# Autodesk Inventor assembly: 2
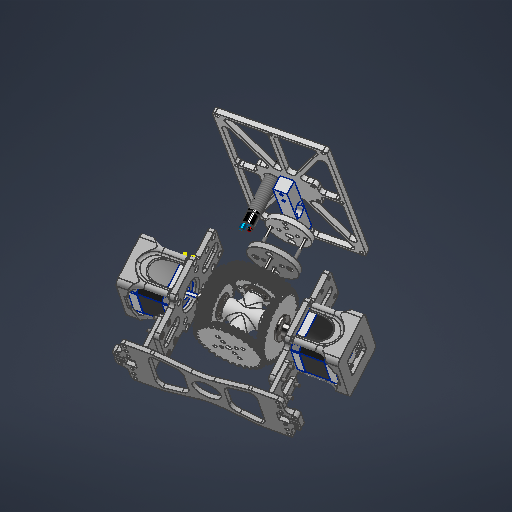
[picture p0: Inventor's stored thumbnail of the model, 512x512]
Saved by Autodesk Inventor 2026.2 (Build 302298010, 298A)
## iProperties
Created: 2026-03-18
Part Number: 2
Document SubType Name: Assembly
Designer: work
Author: work
## Documents named in this file (31)
- C:\Users\work\Desktop\ARD_v1\ARD_hardware\ARD_Model_v1\2.iam
- C:\Users\work\Desktop\ARD_v1\ARD_hardware\ARD_Model_v1\1\A.ipt
- C:\Users\work\Desktop\ARD_v1\ARD_hardware\ARD_Model_v1\C.ipt
- C:\Users\work\Desktop\ARD_v1\ARD_hardware\ARD_Model_v1\Object\JIS B 1521 SKF (D) - SKF 608-Z.ipt
- C:\Users\work\Desktop\ARD_v1\ARD_hardware\ARD_Model_v1\5_Co.ipt
- C:\Users\work\Desktop\ARD_v1\ARD_hardware\ARD_Model_v1\NEMA17.ipt
- C:\Users\work\Desktop\ARD_v1\ARD_hardware\ARD_Model_v1\1\B.ipt
- C:\Users\work\Desktop\ARD_v1\ARD_hardware\ARD_Model_v1\R-2.ipt
- C:\Users\work\Desktop\ARD_v1\ARD_hardware\ARD_Model_v1\Object\로드셀 센서.ipt
- C:\Users\work\Desktop\ARD_v1\ARD_hardware\ARD_Model_v1\as5600_holder.ipt
- C:\Users\work\Desktop\ARD_v1\ARD_hardware\ARD_Model_v1\hol.ipt
- C:\Users\work\Desktop\ARD_v1\ARD_hardware\ARD_Model_v1\RALI1.ipt
- C:\Users\work\Desktop\ARD_v1\ARD_hardware\ARD_Model_v1\magnet_as5600.ipt
- C:\Users\work\Documents\Inventor\Content Center Files\R2026\ko-KR\KS B 1003\KS B 1003 - M 3 x 10.ipt
- C:\Users\work\Desktop\ARD_v1\ARD_hardware\ARD_Model_v1\lj12.ipt
- C:\Users\work\Desktop\ARD_v1\ARD_hardware\ARD_Model_v1\coupler.ipt
- C:\Users\work\Desktop\ARD_v1\ARD_hardware\PL121248Drive_v1\R2-v2.ipt
- C:\Users\work\Desktop\ARD_v1\ARD_hardware\ARD_Model_v1\KS B 1003 - M 3 x 30.ipt
- C:\Users\work\Desktop\ARD_v1\ARD_hardware\ARD_Model_v1\KS B 1003 - M 4 x 10.ipt
- C:\Users\work\Desktop\ARD_v1\ARD_hardware\ARD_Model_v1\2B_set\AIP\FEA\fdflh83ds.fins
- C:\Users\work\Desktop\ARD_v1\ARD_hardware\ARD_Model_v1\2B_set\AIP\FEA\fdflh83ds.fsat
- C:\Users\work\Desktop\ARD_v1\ARD_hardware\ARD_Model_v1\2B_set\AIP\FEA\fdflh83ds.ftes
- C:\Users\work\Desktop\ARD_v1\ARD_hardware\ARD_Model_v1\2B_set\AIP\FEA\fdflh83ds.fwiz
- C:\Users\work\Desktop\ARD_v1\ARD_hardware\ARD_Model_v1\2B_set_rali\AIP\FEA\fdjqx1t5s.fins
- C:\Users\work\Desktop\ARD_v1\ARD_hardware\ARD_Model_v1\2B_set_rali\AIP\FEA\fdjqx1t5s.fsat
- C:\Users\work\Desktop\ARD_v1\ARD_hardware\ARD_Model_v1\2B_set_rali\AIP\FEA\fdjqx1t5s.ftes
- C:\Users\work\Desktop\ARD_v1\ARD_hardware\ARD_Model_v1\2B_set_rali\AIP\FEA\fdjqx1t5s.fwiz
- C:\Users\work\Desktop\ARD_v1\ARD_hardware\ARD_Model_v1\2\AIP\FEA\fdyt8wk5c.fins
- C:\Users\work\Desktop\ARD_v1\ARD_hardware\ARD_Model_v1\2\AIP\FEA\fdyt8wk5c.fsat
- C:\Users\work\Desktop\ARD_v1\ARD_hardware\ARD_Model_v1\2\AIP\FEA\fdyt8wk5c.ftes
- C:\Users\work\Desktop\ARD_v1\ARD_hardware\ARD_Model_v1\2\AIP\FEA\fdyt8wk5c.fwiz
## Components (38 placed, 18 different names)
1. lj12:1 — 회전:48
2. R2-v2:1 — 회전:48, 메이트:70, 메이트:71, 메이트:72, 회전:49, 회전:50, 각도:8
3. coupler:1 — 회전:44, 회전:45, 메이트:68, 메이트:69, 플러쉬:5
4. KS B 1003 - M 3 x 30:1 — 회전:45, 플러쉬:6
5. KS B 1003 - M 3 x 30:2 — 회전:44
6. KS B 1003 - M 3 x 30:3 — 회전:46, 메이트:68, 플러쉬:5
7. KS B 1003 - M 3 x 30:4 — 회전:47, 메이트:69
8. KS B 1003 - M 4 x 10:1 — 회전:49
9. KS B 1003 - M 4 x 10:2 — 회전:50
10. as5600_holder:2 — 메이트:55, 메이트:56, 메이트:57
11. hol:2 — 메이트:53, 메이트:54, 각도:7, 메이트:56, 메이트:57, 메이트:61, 메이트:62, 메이트:63, 강체:3, 회전:37, 회전:38, 회전:39
12. hol:1 — 메이트:51, 각도:5, 메이트:52, 메이트:58, 메이트:59, 회전:40, 회전:41, 회전:42, 회전:43
13. RALI1:1 — 메이트:61, 메이트:62, 메이트:63, 각도:8
14. as5600_holder:1 — 메이트:58, 메이트:59, 메이트:60
15. B:2 — 회전:3
16. R-2:1 — 메이트:35, 메이트:36, 메이트:38, 메이트:39, 메이트:47, 회전:46, 회전:47
17. A:1 — 메이트:1, 메이트:2, 메이트:11, 메이트:19, 메이트:22, 메이트:23, 회전:1, 각도:1
18. C:1 — 메이트:7, 메이트:8, 메이트:9, 메이트:10, 메이트:11, 메이트:27, 각도:4, 메이트:50, 플러쉬:3
19. A:2 — 메이트:10, 메이트:20, 메이트:21, 메이트:24, 회전:2
20. 5_Co:4 — 메이트:22, 메이트:23, 메이트:54
21. 5_Co:3 — 메이트:15, 플러쉬:1, 메이트:21, 메이트:24, 회전:3
22. B:1 — 메이트:25, 메이트:26, 메이트:27, 회전:1, 회전:2, 메이트:35, 메이트:36, 플러쉬:6
23. JIS B 1521 SKF (D) - SKF 608-Z:4 — 메이트:50, 플러쉬:3
24. KS B 1003 - 미터 M 3 x 10:13 — 회전:38
25. KS B 1003 - 미터 M 3 x 10:14 — 회전:37
26. KS B 1003 - 미터 M 3 x 10:15 — 회전:39
27. KS B 1003 - 미터 M 3 x 10:16 — 강체:3
28. KS B 1003 - 미터 M 3 x 10:17 — 회전:41
29. KS B 1003 - 미터 M 3 x 10:18 — 회전:42
30. KS B 1003 - 미터 M 3 x 10:19 — 회전:43
31. KS B 1003 - 미터 M 3 x 10:20 — 회전:40
32. magnet_as5600:2 — 메이트:66, 메이트:67
33. JIS B 1521 SKF (D) - SKF 608-Z:2 — 메이트:8
34. JIS B 1521 SKF (D) - SKF 608-Z:3 — 메이트:7, 메이트:25, 메이트:26
35. JIS B 1521 SKF (D) - SKF 608-Z:1 — 메이트:1, 메이트:2, 메이트:9
36. NEMA17:1 — 메이트:15, 플러쉬:1, 메이트:20, 각도:4, 메이트:51, 각도:5, 각도:6, 메이트:52, 메이트:60, 메이트:66, 메이트:67
37. NEMA17:2 — 메이트:19, 각도:1, 각도:6, 메이트:53, 각도:7, 메이트:55
38. 로드셀 센서:1 — 메이트:38, 메이트:39, 메이트:47, 메이트:70, 메이트:71, 메이트:72
## Relationships (77: Mate 48, RevoluteJoint 14, Angle 6, Flush 5, RelateRotation 3, WeldJoint 1)
- 메이트:1 [Mate]: A:1 ↔ JIS B 1521 SKF (D) - SKF 608-Z:1
- 메이트:2 [Mate]: A:1 ↔ JIS B 1521 SKF (D) - SKF 608-Z:1
- [Mate]: A:2 ↔ JIS B 1521 SKF (D) - SKF 608-Z:2
- [Mate]: A:2 ↔ JIS B 1521 SKF (D) - SKF 608-Z:2
- 메이트:7 [Mate]: C:1 ↔ JIS B 1521 SKF (D) - SKF 608-Z:3
- 메이트:8 [Mate]: C:1 ↔ JIS B 1521 SKF (D) - SKF 608-Z:2
- 메이트:9 [Mate]: C:1 ↔ JIS B 1521 SKF (D) - SKF 608-Z:1
- 메이트:10 [Mate]: C:1 ↔ A:2
- 메이트:11 [Mate]: A:1 ↔ C:1
- 메이트:15 [Mate]: 5_Co:3 ↔ NEMA17:1
- 플러쉬:1 [Flush]: 5_Co:3 ↔ NEMA17:1
- [Mate]: 5_Co:4 ↔ NEMA17:2
- [Flush]: 5_Co:4 ↔ NEMA17:2
- 메이트:19 [Mate]: A:1 ↔ NEMA17:2
- 메이트:20 [Mate]: A:2 ↔ NEMA17:1
- 메이트:21 [Mate]: A:2 ↔ 5_Co:3
- 메이트:22 [Mate]: A:1 ↔ 5_Co:4
- 메이트:23 [Mate]: A:1 ↔ 5_Co:4
- 메이트:24 [Mate]: A:2 ↔ 5_Co:3
- 메이트:25 [Mate]: B:1 ↔ JIS B 1521 SKF (D) - SKF 608-Z:3
- 메이트:26 [Mate]: B:1 ↔ JIS B 1521 SKF (D) - SKF 608-Z:3
- 메이트:27 [Mate]: C:1 ↔ B:1
- 회전:1 [RelateRotation] (1 ul): A:1 ↔ B:1
- 회전:2 [RelateRotation] (1 ul): A:2 ↔ B:1
- 각도:1 [Angle] (720 deg): A:1 ↔ NEMA17:2
- 각도:4 [Angle] (180 deg): C:1 ↔ NEMA17:1
- 메이트:35 [Mate]: R-2:1 ↔ B:1
- 메이트:36 [Mate]: R-2:1 ↔ B:1
- 메이트:38 [Mate]: R-2:1 ↔ 로드셀 센서:1
- 메이트:39 [Mate]: R-2:1 ↔ 로드셀 센서:1
- 메이트:47 [Mate]: R-2:1 ↔ 로드셀 센서:1
- [Mate]: B:2 ↔ JIS B 1521 SKF (D) - SKF 608-Z:4
- [Mate]: B:2 ↔ JIS B 1521 SKF (D) - SKF 608-Z:4
- 메이트:50 [Mate]: C:1 ↔ JIS B 1521 SKF (D) - SKF 608-Z:4
- 플러쉬:3 [Flush]: C:1 ↔ JIS B 1521 SKF (D) - SKF 608-Z:4
- 회전:3 [RelateRotation] (1 ul): B:2 ↔ 5_Co:3
- 메이트:51 [Mate]: hol:1 ↔ NEMA17:1
- 각도:5 [Angle] (0 deg): hol:1 ↔ NEMA17:1
- 각도:6 [Angle] (0 deg): NEMA17:1 ↔ NEMA17:2
- 메이트:52 [Mate]: hol:1 ↔ NEMA17:1
- 메이트:53 [Mate]: hol:2 ↔ NEMA17:2
- 메이트:54 [Mate]: hol:2 ↔ 5_Co:4
- 각도:7 [Angle] (0 deg): hol:2 ↔ NEMA17:2
- 메이트:55 [Mate] (1 mm): as5600_holder:2 ↔ NEMA17:2
- 메이트:56 [Mate]: as5600_holder:2 ↔ hol:2
- 메이트:57 [Mate]: as5600_holder:2 ↔ hol:2
- 메이트:58 [Mate]: hol:1 ↔ as5600_holder:1
- 메이트:59 [Mate]: hol:1 ↔ as5600_holder:1
- 메이트:60 [Mate] (1 mm): as5600_holder:1 ↔ NEMA17:1
- 메이트:61 [Mate]: hol:2 ↔ RALI1:1
- 메이트:62 [Mate]: hol:2 ↔ RALI1:1
- 메이트:63 [Mate]: hol:2 ↔ RALI1:1
- 메이트:66 [Mate]: magnet_as5600:2 ↔ NEMA17:1
- 메이트:67 [Mate]: magnet_as5600:2 ↔ NEMA17:1
- 강체:3 [WeldJoint]: hol:2 ↔ KS B 1003 - 미터 M 3 x 10:16
- 회전:37 [RevoluteJoint]: hol:2 ↔ KS B 1003 - 미터 M 3 x 10:14
- 회전:38 [RevoluteJoint]: hol:2 ↔ KS B 1003 - 미터 M 3 x 10:13
- 회전:39 [RevoluteJoint]: hol:2 ↔ KS B 1003 - 미터 M 3 x 10:15
- 회전:40 [RevoluteJoint]: hol:1 ↔ KS B 1003 - 미터 M 3 x 10:20
- 회전:41 [RevoluteJoint]: hol:1 ↔ KS B 1003 - 미터 M 3 x 10:17
- 회전:42 [RevoluteJoint]: hol:1 ↔ KS B 1003 - 미터 M 3 x 10:18
- 회전:43 [RevoluteJoint]: hol:1 ↔ KS B 1003 - 미터 M 3 x 10:19
- 회전:44 [RevoluteJoint]: coupler:1 ↔ KS B 1003 - M 3 x 30:2
- 회전:45 [RevoluteJoint]: coupler:1 ↔ KS B 1003 - M 3 x 30:1
- 회전:46 [RevoluteJoint]: KS B 1003 - M 3 x 30:3 ↔ R-2:1
- 회전:47 [RevoluteJoint]: KS B 1003 - M 3 x 30:4 ↔ R-2:1
- 메이트:68 [Mate]: coupler:1 ↔ KS B 1003 - M 3 x 30:3
- 메이트:69 [Mate]: coupler:1 ↔ KS B 1003 - M 3 x 30:4
- 플러쉬:5 [Flush]: coupler:1 ↔ KS B 1003 - M 3 x 30:3
- 플러쉬:6 [Flush]: KS B 1003 - M 3 x 30:1 ↔ B:1
- 회전:48 [RevoluteJoint]: lj12:1 ↔ R2-v2:1
- 메이트:70 [Mate]: R2-v2:1 ↔ 로드셀 센서:1
- 메이트:71 [Mate]: R2-v2:1 ↔ 로드셀 센서:1
- 메이트:72 [Mate]: R2-v2:1 ↔ 로드셀 센서:1
- 회전:49 [RevoluteJoint]: R2-v2:1 ↔ KS B 1003 - M 4 x 10:1
- 회전:50 [RevoluteJoint]: R2-v2:1 ↔ KS B 1003 - M 4 x 10:2
- 각도:8 [Angle] (0 deg): R2-v2:1 ↔ RALI1:1
## Named parameters: d3_d1 = 0 mm, d4_d2 = 0 mm, d19_d15 = 0 mm, d20_d16 = 0 mm, sa_0 = 10000, d161_d108 = 0 mm, d162_d109 = 0 mm
note: some values were not read from the file. Shown as the stored number, unit unknown: "sa_0".
